# Autodesk Inventor assembly: Montagem articulado
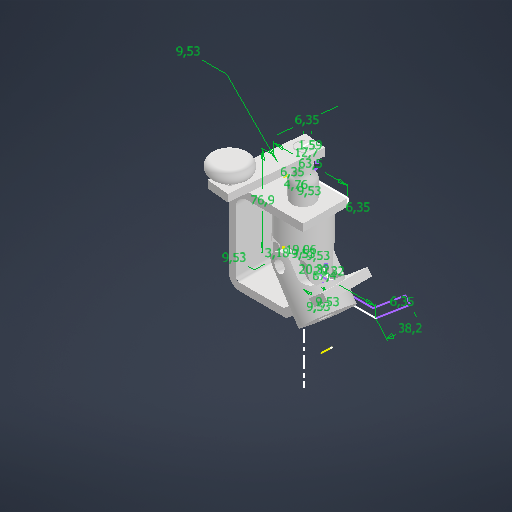
[picture p0: Inventor's stored thumbnail of the model, 512x512]
Saved by Autodesk Inventor 2026.2 (Build 302298000, 298)
## iProperties
Created: 2026-10-09
Part Number: Montagem articulado
Document SubType Name: Assembly
Designer: IFSP
Author: IFSP
## Documents named in this file (9)
- D:\Montagem articulado.iam
- D:\ARTICULADO 1.ipt
- D:\ARTICULADO 9.ipt
- D:\ARTICULADO 8.ipt
- D:\ARTICULADO 7.ipt
- C:\Users\IFSP\Documents\Inventor\Content Center Files\R2026\pt-BR\ISO 8734 (A)\ISO 8734 - 2,5 x 12 - AISO (1).ipt
- D:\ARTICULADO 2S.ipt
- D:\ARTICULADO 3.ipt
- D:\ARTICULADO 4.ipt
## Components (8 placed, 8 different names)
1. ARTICULADO 1:1 — Coincidente:7, Coincidente:8, Coincidente:9
2. ARTICULADO 9:1 — Coincidente:1, Coincidente:2
3. ARTICULADO 8:1 — Coincidente:1, Coincidente:2, Coincidente:3, Coincidente:4, Coincidente:6
4. ARTICULADO 7:1 — Coincidente:3, Coincidente:4, Coincidente:5, Coincidente:6, Coincidente:9, Coincidente:10
5. ISO 8734 A 2,5 x 12 - A:1 — Coincidente:10
6. ARTICULADO 2S:1 — Coincidente:5, Coincidente:7, Coincidente:8, Coincidente:11, Coincidente:12
7. ARTICULADO 3:1 — Coincidente:11, Coincidente:12, Coincidente:13, Coincidente:14
8. ARTICULADO 4:2 — Coincidente:13, Coincidente:14
## Relationships (14: Mate 14)
- Coincidente:1 [Mate]: ARTICULADO 9:1 ↔ ARTICULADO 8:1
- Coincidente:2 [Mate]: ARTICULADO 9:1 ↔ ARTICULADO 8:1
- Coincidente:3 [Mate]: ARTICULADO 8:1 ↔ ARTICULADO 7:1
- Coincidente:4 [Mate]: ARTICULADO 8:1 ↔ ARTICULADO 7:1
- Coincidente:5 [Mate]: ARTICULADO 7:1 ↔ ARTICULADO 2S:1
- Coincidente:6 [Mate]: ARTICULADO 8:1 ↔ ARTICULADO 7:1
- Coincidente:7 [Mate]: ARTICULADO 1:1 ↔ ARTICULADO 2S:1
- Coincidente:8 [Mate]: ARTICULADO 1:1 ↔ ARTICULADO 2S:1
- Coincidente:9 [Mate]: ARTICULADO 1:1 ↔ ARTICULADO 7:1
- Coincidente:10 [Mate]: ARTICULADO 7:1 ↔ ISO 8734 A 2,5 x 12 - A:1
- Coincidente:11 [Mate]: ARTICULADO 2S:1 ↔ ARTICULADO 3:1
- Coincidente:12 [Mate] (0.1 mm): ARTICULADO 2S:1 ↔ ARTICULADO 3:1
- Coincidente:13 [Mate]: ARTICULADO 3:1 ↔ ARTICULADO 4:2
- Coincidente:14 [Mate]: ARTICULADO 3:1 ↔ ARTICULADO 4:2
